# Autodesk Inventor assembly: 6987 TP-494x1244x42
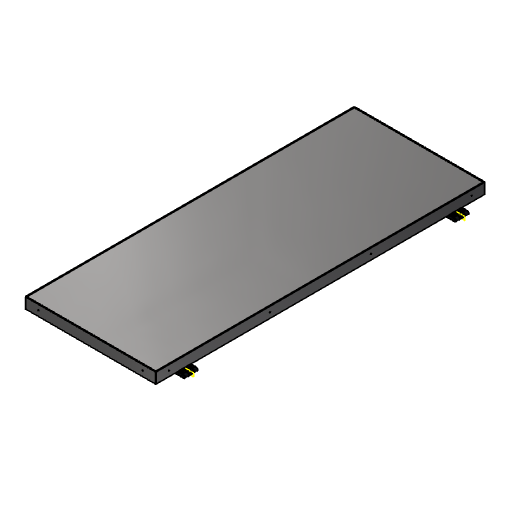
[picture p0: Inventor's stored thumbnail of the model, 512x512]
Saved by Autodesk Inventor 2024.3 (Build 283343000, 343)
## iProperties
RuleStatus: InUse
Created: 2019-06-24
Part Number: 6987 TP-494x1244x42
Material: Generisch
Document SubType Name: Assembly
Designer: MK
Mass: 12781.9 g
Surface Area: 31551.1 cm^2
Volume: 1787.13 cm^3
Density: 7.15222 g/cm^3
Description: Tür-Paneel
InventorSizerSetup: TP 1T 1
Author: MK
## Documents named in this file (5)
- C:\Users\la\Documents\GitHub\Inventor_Sizer\C# Version\GR\Einzelteile\6987 TP-494x1244x42.iam
- C:\Users\la\Documents\GitHub\Inventor_Sizer\C# Version\MODELS\Scharnier.iam
- C:\Users\la\Documents\GitHub\Inventor_Sizer\C# Version\MODELS\Türgriff abschließbar.iam
- C:\Users\la\Documents\GitHub\Inventor_Sizer\C# Version\GR\Einzelteile\6987 494x1244x42-Au.ipt
- C:\Users\la\Documents\GitHub\Inventor_Sizer\C# Version\GR\Einzelteile\6987 494x1244x42-In.ipt
## Components (6 placed, 4 different names)
1. 6987 494x1244x42-Au:1 — Mate:6, Mate:7, Mate:8, Mate:9, Mate:10, Mate:11, Mate:12
2. 6987 494x1244x42-In:1 — Mate:6, Mate:7, Mate:8
3. Türgriff abschließbar:4 [sub-assembly] — Mate:9, Mate:10, Mate:11
4. Türgriff abschließbar:5 [sub-assembly]
5. Scharnier:2 [sub-assembly] — Mate:12
6. Scharnier:3 [sub-assembly]
## Component patterns: (2 elements, first: Türgriff abschließbar:4), (2 elements, first: Scharnier:2)
## Relationships (7: Mate 7)
- Mate:6: 6987 494x1244x42-Au:1 ↔ 6987 494x1244x42-In:1
- Mate:7 (0.5 mm): 6987 494x1244x42-Au:1 ↔ 6987 494x1244x42-In:1
- Mate:8 (0.5 mm): 6987 494x1244x42-Au:1 ↔ 6987 494x1244x42-In:1
- Mate:9: 6987 494x1244x42-Au:1 ↔ Türgriff abschließbar:4
- Mate:10: 6987 494x1244x42-Au:1 ↔ Türgriff abschließbar:4
- Mate:11: 6987 494x1244x42-Au:1 ↔ Türgriff abschließbar:4
- Mate:12: 6987 494x1244x42-Au:1 ↔ Scharnier:2
## Named parameters: Clearance = 0.5 mm, HingeCount = 2, HingePitch = 1024 mm, HandleCount = 2, HandlePitch = 844 mm, Width = 494 mm
